# Autodesk Inventor assembly: Product 1
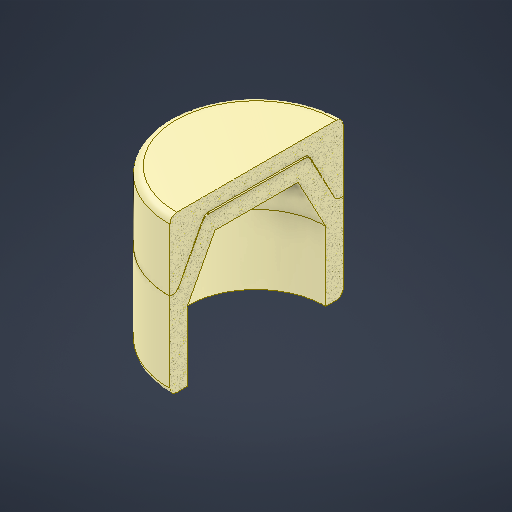
[picture p0: Inventor's stored thumbnail of the model, 512x512]
Saved by Autodesk Inventor 2027.1 (Build 311270010, 270A)
## iProperties
Created: 2026-10-02
Part Number: Product 1
Document SubType Name: Assembly
Designer: Ahmed
Author: Ahmed
## Documents named in this file (3)
- C:\Users\Ahmed\Desktop\Fall 26\MCT333 Design of Mechatronics Systems 1\Project\CAD\Product 1.iam
- C:\Users\Ahmed\Desktop\Fall 26\MCT333 Design of Mechatronics Systems 1\Project\CAD\Product Base.ipt
- C:\Users\Ahmed\Desktop\Fall 26\MCT333 Design of Mechatronics Systems 1\Project\CAD\Product Lid.ipt
## Components (2 placed, 2 different names)
1. Product Base:1 — Mate:1, Mate:2
2. Product Lid:1 — Mate:1, Mate:2
## Relationships (2: Mate 2)
- Mate:1: Product Base:1 ↔ Product Lid:1
- Mate:2: Product Base:1 ↔ Product Lid:1
